# Autodesk Inventor assembly: Assembly1
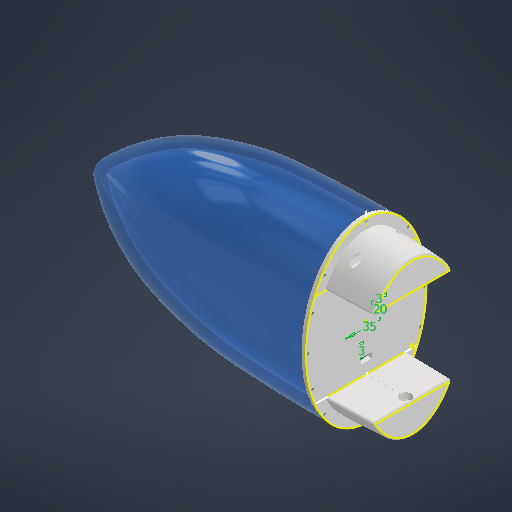
[picture p0: Inventor's stored thumbnail of the model, 512x512]
Saved by Autodesk Inventor 2027 (Build 310192060, 192F)
## iProperties
Created: 2026-06-12
Part Number: Assembly1
Document SubType Name: Assembly
Designer: thita
Author: thita
## Documents named in this file (3)
- D:\Year2\đồ án tốt nghịp\new fish\NEW7\Workgroups\NotInProject\Assembly1.iam
- D:\Year2\đồ án tốt nghịp\new fish\NEW7\Workgroups\NotInProject\DESIGN\Workgroups\NotInProject\NotInProject\DAU.ipt
- D:\Year2\đồ án tốt nghịp\new fish\NEW7\Workgroups\NotInProject\DESIGN\Workgroups\NotInProject\NotInProject\NAP.ipt
## Components (2 placed, 2 different names)
1. DAU:1 — Rigid:1
2. NAP:1 — Rigid:1
## Relationships (1: WeldJoint 1)
- Rigid:1 [WeldJoint]: DAU:1 ↔ NAP:1
## Named parameters: Finish3_Area = 16.8006, Finish4_Area = 23.6105, Finish5_Area = 23.6105, Finish6_Area = 1.06717
note: some values were not read from the file. Shown as the stored number, unit unknown: "Finish3_Area", "Finish4_Area", "Finish5_Area", "Finish6_Area".
